# Autodesk Inventor assembly: SpaceX Assembly
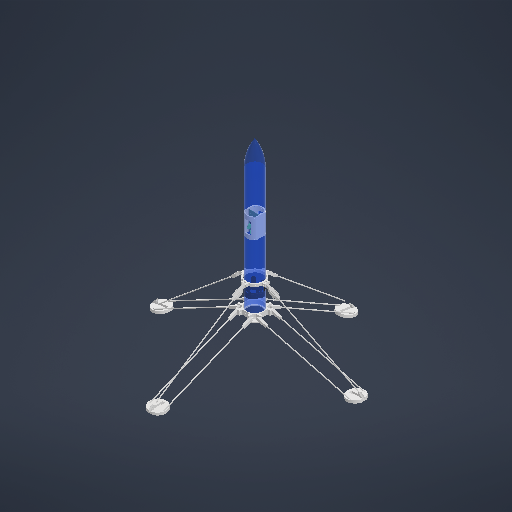
[picture p0: Inventor's stored thumbnail of the model, 512x512]
Saved by Autodesk Inventor 2027 (Build 310192060, 192F)
## iProperties
Created: 2026-06-28
Part Number: SpaceX Assembly
Document SubType Name: Assembly
Designer: troop
Author: troop
## Documents named in this file (15)
- C:\Users\troop\OneDrive\Documents\Inventor\SpaceX Rocket\SpaceX Assembly.iam
- Self landing TVC Assembly.iam
- C:\Users\troop\OneDrive\Documents\Inventor\SpaceX Rocket\Body_1.ipt
- C:\Users\troop\OneDrive\Documents\Inventor\SpaceX Rocket\Outer GImbal.ipt
- C:\Users\troop\OneDrive\Documents\Inventor\SpaceX Rocket\Inner GImbal.ipt
- C:\Users\troop\OneDrive\Documents\Inventor\SpaceX Rocket\Upper leg.ipt
- Upper leg_4.ipt
- C:\Users\troop\OneDrive\Documents\Inventor\SpaceX Rocket\Upper leg connector to UL Ring_4.ipt
- C:\Users\troop\OneDrive\Documents\Inventor\SpaceX Rocket\Lower leg to lower G connector_8.ipt
- C:\Users\troop\OneDrive\Documents\Inventor\SpaceX Rocket\Lower leg_8.ipt
- C:\Users\troop\OneDrive\Documents\Inventor\SpaceX Rocket\Landing Leg pad_4.ipt
- C:\Users\troop\OneDrive\Documents\Inventor\SpaceX Rocket\Upper leg ring_1 V2.ipt
- C:\Users\troop\OneDrive\Documents\Inventor\SpaceX Rocket\Lower leg ring_1 V2.ipt
- C:\Users\troop\OneDrive\Documents\KiCad\Rocket electronics\Icarus Flight computer\Icarus Flight computer.iam
- C:\Users\troop\OneDrive\Documents\Inventor\SpaceX Rocket\Avionics Holder.ipt
## Components (35 placed, 12 different names)
1. Body_1:1 — Mate:10, Mate:80, Mate:81, Mate:82, Mate:107
2. Outer GImbal:1 — Mate:9, Flush:8, Tangent:1, Mate:10
3. Inner GImbal:1 — Mate:9, Flush:8, Tangent:1, Flush:9
4. Upper leg_4:1 — Mate:23, Mate:24
5. Upper leg_4:2 — Mate:19, Mate:20
6. Upper leg_4:3 — Mate:25, Mate:26
7. Upper leg_4:4 — Mate:21, Mate:22
8. Upper leg connector to UL Ring_4:1 — Mate:19, Mate:20, Mate:96, Mate:97
9. Upper leg connector to UL Ring_4:2 — Mate:21, Mate:22, Mate:98, Mate:99
10. Upper leg connector to UL Ring_4:3 — Mate:23, Mate:24, Mate:100, Mate:101
11. Upper leg connector to UL Ring_4:4 — Mate:25, Mate:26, Mate:102, Mate:103
12. Lower leg to lower G connector_8:1 — Mate:41, Mate:42, Mate:83, Mate:84
13. Lower leg to lower G connector_8:2 — Mate:39, Mate:40, Mate:87
14. Lower leg_8:1 — Mate:41, Mate:42, Mate:67, Mate:68
15. Lower leg_8:2 — Mate:39, Mate:40, Mate:72
16. Lower leg to lower G connector_8:3 — Mate:47, Mate:48, Mate:94
17. Lower leg to lower G connector_8:4 — Mate:49, Mate:50, Mate:85, Mate:86
18. Lower leg_8:3 — Mate:47, Mate:48, Mate:75
19. Lower leg_8:4 — Mate:49, Mate:50, Mate:71, Mate:73
20. Lower leg to lower G connector_8:5 — Mate:55, Mate:56, Mate:92, Mate:93
21. Lower leg to lower G connector_8:6 — Mate:57, Mate:58, Mate:91
22. Lower leg_8:5 — Mate:65, Mate:66, Mate:69, Mate:70
23. Lower leg_8:6 — Mate:63, Mate:64, Mate:77, Mate:79
24. Lower leg_8:7 — Mate:57, Mate:58, Mate:78
25. Lower leg_8:8 — Mate:55, Mate:56, Mate:74, Mate:76
26. Lower leg to lower G connector_8:7 — Mate:63, Mate:64, Mate:89, Mate:90
27. Lower leg to lower G connector_8:8 — Mate:65, Mate:66, Mate:88
28. Landing Leg pad_4:1 — Mate:67, Mate:68, Mate:69, Mate:70
29. Landing Leg pad_4:2 — Mate:71, Mate:72, Mate:73
30. Landing Leg pad_4:3 — Mate:74, Mate:75, Mate:76
31. Landing Leg pad_4:4 — Mate:77, Mate:78, Mate:79
32. Upper leg ring_1:1 — Mate:82, Mate:95, Mate:96, Mate:97, Mate:98, Mate:99, Mate:100, Mate:101, Mate:102, Mate:103
33. Lower leg ring_1 V3:1 — Mate:80, Mate:81, Mate:83, Mate:84, Mate:85, Mate:86, Mate:87, Mate:88, Mate:89, Mate:90, Mate:91, Mate:92, Mate:93, Mate:94, Mate:95, Flush:9
34. Icarus Flight computer:1 [sub-assembly] — Mate:104, Mate:105, Mate:106
35. Avionics Holder:1 — Mate:104, Mate:105, Mate:106, Mate:107
## Relationships (70: Mate 67, Flush 2, Tangent 1)
- Mate:9: Outer GImbal:1 ↔ Inner GImbal:1
- Flush:8: Outer GImbal:1 ↔ Inner GImbal:1
- Tangent:1: Outer GImbal:1 ↔ Inner GImbal:1
- Mate:10: Body_1:1 ↔ Outer GImbal:1
- Mate:19: Upper leg_4:2 ↔ Upper leg connector to UL Ring_4:1
- Mate:20: Upper leg_4:2 ↔ Upper leg connector to UL Ring_4:1
- Mate:21: Upper leg_4:4 ↔ Upper leg connector to UL Ring_4:2
- Mate:22: Upper leg_4:4 ↔ Upper leg connector to UL Ring_4:2
- Mate:23: Upper leg_4:1 ↔ Upper leg connector to UL Ring_4:3
- Mate:24: Upper leg_4:1 ↔ Upper leg connector to UL Ring_4:3
- Mate:25: Upper leg_4:3 ↔ Upper leg connector to UL Ring_4:4
- Mate:26: Upper leg_4:3 ↔ Upper leg connector to UL Ring_4:4
- Mate:39: Lower leg to lower G connector_8:2 ↔ Lower leg_8:2
- Mate:40: Lower leg to lower G connector_8:2 ↔ Lower leg_8:2
- Mate:41: Lower leg to lower G connector_8:1 ↔ Lower leg_8:1
- Mate:42: Lower leg to lower G connector_8:1 ↔ Lower leg_8:1
- Mate:47: Lower leg to lower G connector_8:3 ↔ Lower leg_8:3
- Mate:48: Lower leg to lower G connector_8:3 ↔ Lower leg_8:3
- Mate:49: Lower leg to lower G connector_8:4 ↔ Lower leg_8:4
- Mate:50: Lower leg to lower G connector_8:4 ↔ Lower leg_8:4
- Mate:55: Lower leg to lower G connector_8:5 ↔ Lower leg_8:8
- Mate:56: Lower leg to lower G connector_8:5 ↔ Lower leg_8:8
- Mate:57: Lower leg to lower G connector_8:6 ↔ Lower leg_8:7
- Mate:58: Lower leg to lower G connector_8:6 ↔ Lower leg_8:7
- Mate:63: Lower leg_8:6 ↔ Lower leg to lower G connector_8:7
- Mate:64: Lower leg_8:6 ↔ Lower leg to lower G connector_8:7
- Mate:65: Lower leg_8:5 ↔ Lower leg to lower G connector_8:8
- Mate:66: Lower leg_8:5 ↔ Lower leg to lower G connector_8:8
- Mate:67: Lower leg_8:1 ↔ Landing Leg pad_4:1
- Mate:68: Lower leg_8:1 ↔ Landing Leg pad_4:1
- Mate:69: Lower leg_8:5 ↔ Landing Leg pad_4:1
- Mate:70: Lower leg_8:5 ↔ Landing Leg pad_4:1
- Mate:71: Lower leg_8:4 ↔ Landing Leg pad_4:2
- Mate:72: Lower leg_8:2 ↔ Landing Leg pad_4:2
- Mate:73: Lower leg_8:4 ↔ Landing Leg pad_4:2
- Mate:74: Lower leg_8:8 ↔ Landing Leg pad_4:3
- Mate:75: Lower leg_8:3 ↔ Landing Leg pad_4:3
- Mate:76: Lower leg_8:8 ↔ Landing Leg pad_4:3
- Mate:77: Lower leg_8:6 ↔ Landing Leg pad_4:4
- Mate:78: Lower leg_8:7 ↔ Landing Leg pad_4:4
- Mate:79: Lower leg_8:6 ↔ Landing Leg pad_4:4
- Mate:80: Body_1:1 ↔ Lower leg ring_1 V3:1
- Mate:81: Body_1:1 ↔ Lower leg ring_1 V3:1
- Mate:82: Body_1:1 ↔ Upper leg ring_1:1
- Mate:83: Lower leg to lower G connector_8:1 ↔ Lower leg ring_1 V3:1
- Mate:84: Lower leg to lower G connector_8:1 ↔ Lower leg ring_1 V3:1
- Mate:85: Lower leg to lower G connector_8:4 ↔ Lower leg ring_1 V3:1
- Mate:86: Lower leg to lower G connector_8:4 ↔ Lower leg ring_1 V3:1
- Mate:87: Lower leg to lower G connector_8:2 ↔ Lower leg ring_1 V3:1
- Mate:88: Lower leg to lower G connector_8:8 ↔ Lower leg ring_1 V3:1
- Mate:89: Lower leg to lower G connector_8:7 ↔ Lower leg ring_1 V3:1
- Mate:90: Lower leg to lower G connector_8:7 ↔ Lower leg ring_1 V3:1
- Mate:91: Lower leg to lower G connector_8:6 ↔ Lower leg ring_1 V3:1
- Mate:92: Lower leg to lower G connector_8:5 ↔ Lower leg ring_1 V3:1
- Mate:93: Lower leg to lower G connector_8:5 ↔ Lower leg ring_1 V3:1
- Mate:94: Lower leg to lower G connector_8:3 ↔ Lower leg ring_1 V3:1
- Mate:95 (134.62 mm): Upper leg ring_1:1 ↔ Lower leg ring_1 V3:1
- Mate:96: Upper leg connector to UL Ring_4:1 ↔ Upper leg ring_1:1
- Mate:97: Upper leg connector to UL Ring_4:1 ↔ Upper leg ring_1:1
- Mate:98: Upper leg connector to UL Ring_4:2 ↔ Upper leg ring_1:1
- Mate:99: Upper leg connector to UL Ring_4:2 ↔ Upper leg ring_1:1
- Mate:100: Upper leg connector to UL Ring_4:3 ↔ Upper leg ring_1:1
- Mate:101: Upper leg connector to UL Ring_4:3 ↔ Upper leg ring_1:1
- Mate:102: Upper leg connector to UL Ring_4:4 ↔ Upper leg ring_1:1
- Mate:103: Upper leg connector to UL Ring_4:4 ↔ Upper leg ring_1:1
- Flush:9 (76.2 mm): Inner GImbal:1 ↔ Lower leg ring_1 V3:1
- Mate:104: Icarus Flight computer:1 ↔ Avionics Holder:1
- Mate:105: Icarus Flight computer:1 ↔ Avionics Holder:1
- Mate:106 (0.762 mm): Icarus Flight computer:1 ↔ Avionics Holder:1
- Mate:107: Body_1:1 ↔ Avionics Holder:1
